# Autodesk Inventor assembly: Hose Assembly
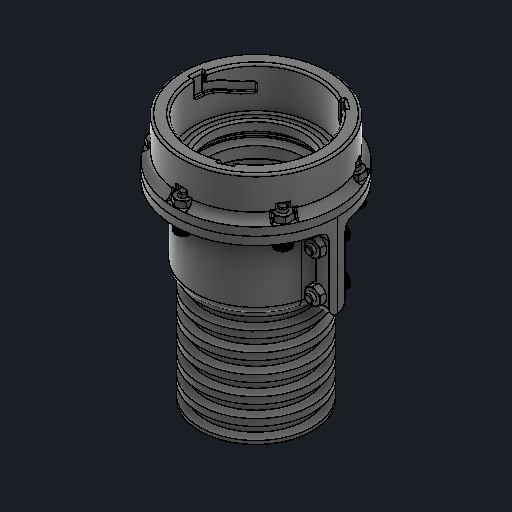
[picture p0: Inventor's stored thumbnail of the model, 512x512]
Saved by Autodesk Inventor 2026.2 (Build 302298000, 298)
## iProperties
Created: 2026-07-12
Part Number: Hose Assembly
Document SubType Name: Assembly
Designer: JoshuaEah
Author: JoshuaEah
## Documents named in this file (6)
- C:\Users\Joshua Eah\Documents\GitHub\designs\40mm Vacuum Hose Attachment System\Assemblies\Nozzle Side Assembly.iam
- C:\Users\Joshua Eah\Documents\GitHub\designs\40mm Vacuum Hose Attachment System\Parts\Flanged Hose Fitting.ipt
- C:\Users\Joshua Eah\Documents\GitHub\designs\40mm Vacuum Hose Attachment System\Parts\40mm Vacuum Hose.ipt
- C:\Users\Joshua Eah\Documents\GitHub\designs\Common Hardware\M3x0.5x10mm SHCS.ipt
- C:\Users\Joshua Eah\Documents\GitHub\designs\Common Hardware\M3x0.5 Hex Nut.ipt
- C:\Users\Joshua Eah\Documents\GitHub\designs\40mm Vacuum Hose Attachment System\Parts\Vacuum Attachments\Flanged Attachment Mount (Choked Base).ipt
## Components (24 placed, 5 different names)
1. Flanged Hose Fitting:1 — Insert:1, Insert:2, Insert:3, Insert:6, Insert:7, Insert:10, Insert:11, Insert:16
2. Flanged Hose Fitting:2 — Insert:1, Insert:2, Insert:4, Insert:5, Insert:8, Insert:9, Insert:15, Insert:14
3. 40mm Vacuum Hose:1 — Insert:3
4. M3x0.5x10mm SHCS:1 — Insert:4
5. M3x0.5x10mm SHCS:2 — Insert:5
6. M3x0.5x10mm SHCS:3 — Insert:6
7. M3x0.5x10mm SHCS:4 — Insert:7
8. M3x0.5 Hex Nut:1 — Insert:8
9. M3x0.5 Hex Nut:2 — Insert:9
10. M3x0.5 Hex Nut:3 — Insert:10
11. M3x0.5 Hex Nut:4 — Insert:11
12. Flanged Attachment Mount (Choked Base):1 — Insert:15, Insert:16, Insert:17
13. M3x0.5x10mm SHCS:5 — Insert:14
14. M3x0.5 Hex Nut:5 — Insert:17
15. M3x0.5x10mm SHCS:6
16. M3x0.5 Hex Nut:6
17. M3x0.5x10mm SHCS:7
18. M3x0.5 Hex Nut:7
19. M3x0.5x10mm SHCS:8
20. M3x0.5 Hex Nut:8
21. M3x0.5x10mm SHCS:9
22. M3x0.5 Hex Nut:9
23. M3x0.5x10mm SHCS:10
24. M3x0.5 Hex Nut:10
## Component patterns: Flange Mounting Hardware (6 elements)
## Relationships (15: Insert 15)
- Insert:1: Flanged Hose Fitting:1 ↔ Flanged Hose Fitting:2
- Insert:2: Flanged Hose Fitting:1 ↔ Flanged Hose Fitting:2
- Insert:3 (0.1 mm): Flanged Hose Fitting:1 ↔ 40mm Vacuum Hose:1
- Insert:4: Flanged Hose Fitting:2 ↔ M3x0.5x10mm SHCS:1
- Insert:5: Flanged Hose Fitting:2 ↔ M3x0.5x10mm SHCS:2
- Insert:6: Flanged Hose Fitting:1 ↔ M3x0.5x10mm SHCS:3
- Insert:7: Flanged Hose Fitting:1 ↔ M3x0.5x10mm SHCS:4
- Insert:8: Flanged Hose Fitting:2 ↔ M3x0.5 Hex Nut:1
- Insert:9: Flanged Hose Fitting:2 ↔ M3x0.5 Hex Nut:2
- Insert:10: Flanged Hose Fitting:1 ↔ M3x0.5 Hex Nut:3
- Insert:11: Flanged Hose Fitting:1 ↔ M3x0.5 Hex Nut:4
- Insert:14: Flanged Hose Fitting:2 ↔ M3x0.5x10mm SHCS:5
- Insert:15: Flanged Hose Fitting:2 ↔ Flanged Attachment Mount (Choked Base):1
- Insert:16: Flanged Hose Fitting:1 ↔ Flanged Attachment Mount (Choked Base):1
- Insert:17: Flanged Attachment Mount (Choked Base):1 ↔ M3x0.5 Hex Nut:5
